# Autodesk Inventor assembly: BoronProbe_2026_non-rotating_slide
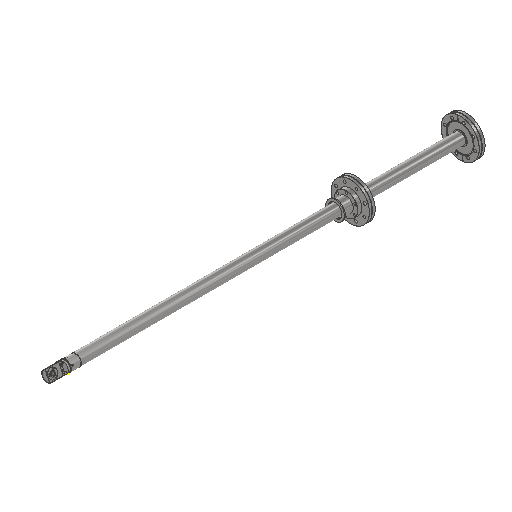
[picture p0: Inventor's stored thumbnail of the model, 512x512]
Saved by Autodesk Inventor 2027.1 (Build 311270010, 270A)
## iProperties
Created: 2026-05-08
Part Number: BoronProbe_2026_non-rotating_slide
Document SubType Name: Assembly
Designer: zetsu
ProbePos: 310.000 mm
Author: zetsu
## Documents named in this file (11)
- D:\repos\PIHTI\BoronProbe_2026\BoronProbe_2026_non-rotating_slide.iam
- D:\repos\PIHTI\BoronProbe_2026\parts\C25K22A4CU.iam
- D:\repos\PIHTI\BoronProbe_2026\parts\ICF70_to_KF40.ipt
- D:\repos\PIHTI\BoronProbe_2026\parts\B_probe_bearing.ipt
- D:\repos\PIHTI\BoronProbe_2026\parts\ICF_114-70_bearing.ipt
- D:\repos\PIHTI\BoronProbe_2026\parts\B_pipe_flange_spacer_5.ipt
- D:\repos\PIHTI\BoronProbe_2026\parts\M4×12-VentedHexBolt.ipt
- D:\repos\PIHTI\Plasma Vessel_2026\contents\ICF_114-70.ipt
- D:\repos\PIHTI\BoronProbe_2026\SampleHolder_1.iam
- D:\repos\PIHTI\BoronProbe_2026\parts\B_probe_pipe_5_for-non-rotating_1.ipt
- D:\repos\PIHTI\BoronProbe_2026\parts\B_pipe_adapter_1.ipt
## Components (12 placed, 10 different names)
1. C25K22A4CU:1 [sub-assembly]
2. ICF_114-70:1 — フラッシュ:7, メイト:173, メイト:177
3. ICF_114-70_bearing:2 — メイト:133, メイト:134, メイト:138, メイト:139, メイト:151, メイト:176, メイト:177
4. ICF70_to_KF40:1 — メイト:133, メイト:134
5. B_probe_bearing:2 — メイト:138, メイト:139, メイト:151, メイト:161, メイト:162, メイト:163, メイト:164, メイト:165, メイト:166
6. B_pipe_flange_spacer_5:1 — フラッシュ:7, メイト:173, メイト:174, メイト:175
7. M4×12-VentedHexBolt:1 — メイト:161, メイト:162
8. M4×12-VentedHexBolt:2 — メイト:163, メイト:164
9. M4×12-VentedHexBolt:3 — メイト:165, メイト:166
10. SampleHolder_1:1 [sub-assembly] — メイト:171, メイト:172
11. B_probe_pipe_5_for-non-rotating_1:1 — メイト:169, メイト:170, メイト:174, メイト:175, メイト:176
12. B_pipe_adapter_1:2 — メイト:169, メイト:170, メイト:171, メイト:172
## Relationships (21: Mate 20, Flush 1)
- メイト:133 [Mate]: ICF_114-70_bearing:2 ↔ ICF70_to_KF40:1
- メイト:134 [Mate]: ICF_114-70_bearing:2 ↔ ICF70_to_KF40:1
- メイト:138 [Mate]: ICF_114-70_bearing:2 ↔ B_probe_bearing:2
- メイト:139 [Mate]: ICF_114-70_bearing:2 ↔ B_probe_bearing:2
- メイト:151 [Mate]: ICF_114-70_bearing:2 ↔ B_probe_bearing:2
- フラッシュ:7 [Flush]: ICF_114-70:1 ↔ B_pipe_flange_spacer_5:1
- メイト:161 [Mate]: B_probe_bearing:2 ↔ M4×12-VentedHexBolt:1
- メイト:162 [Mate]: B_probe_bearing:2 ↔ M4×12-VentedHexBolt:1
- メイト:163 [Mate]: B_probe_bearing:2 ↔ M4×12-VentedHexBolt:2
- メイト:164 [Mate]: B_probe_bearing:2 ↔ M4×12-VentedHexBolt:2
- メイト:165 [Mate]: B_probe_bearing:2 ↔ M4×12-VentedHexBolt:3
- メイト:166 [Mate]: B_probe_bearing:2 ↔ M4×12-VentedHexBolt:3
- メイト:169 [Mate]: B_probe_pipe_5_for-non-rotating_1:1 ↔ B_pipe_adapter_1:2
- メイト:170 [Mate]: B_probe_pipe_5_for-non-rotating_1:1 ↔ B_pipe_adapter_1:2
- メイト:171 [Mate]: SampleHolder_1:1 ↔ B_pipe_adapter_1:2
- メイト:172 [Mate]: SampleHolder_1:1 ↔ B_pipe_adapter_1:2
- メイト:173 [Mate]: ICF_114-70:1 ↔ B_pipe_flange_spacer_5:1
- メイト:174 [Mate]: B_pipe_flange_spacer_5:1 ↔ B_probe_pipe_5_for-non-rotating_1:1
- メイト:175 [Mate]: B_pipe_flange_spacer_5:1 ↔ B_probe_pipe_5_for-non-rotating_1:1
- メイト:176 [Mate]: ICF_114-70_bearing:2 ↔ B_probe_pipe_5_for-non-rotating_1:1
- メイト:177 [Mate] (327.1 mm): ICF_114-70:1 ↔ ICF_114-70_bearing:2
## Named parameters: ProbePos = 310 mm, ProbePos_Max = 276 mm, ProbePos_Min = 1000 mm, ProbePos_Plasma = 660 mm, ProbePos_Spec = 310 mm
